# Autodesk Inventor assembly: iterasi2
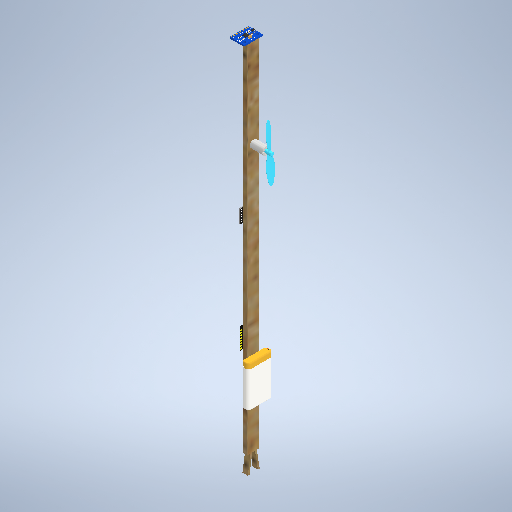
[picture p0: Inventor's stored thumbnail of the model, 512x512]
Saved by Autodesk Inventor 2026.2 (Build 302298010, 298A)
## iProperties
Created: 2026-11-09
Part Number: iterasi2
Document SubType Name: Assembly
Designer: Acer
Author: Acer
## Documents named in this file (8)
- D:\Cool Yeah\Semester 3\Praktikum SKD\Projek-Akhir\3Dmodel\iterasi2.iam
- D:\Cool Yeah\Semester 3\Praktikum SKD\Projek-Akhir\3Dmodel\propeller-65-mm-helice-65mm-1.snapshot.5\helice-ccw-65mm\helice-ccw-65mm\helice-ccw-65mm.ipt
- D:\Cool Yeah\Semester 3\Praktikum SKD\Projek-Akhir\3Dmodel\8520-coreless-brushed-motor-1.snapshot.2\8520 Coreless Brshed motor\8520 Coreless Brshed motor\8520 Coreless Brshed motor.ipt
- D:\Cool Yeah\Semester 3\Praktikum SKD\Projek-Akhir\3Dmodel\MPU6050\MPU6050 Accelerometer\MPU6050 Accelerometer\MPU6050 Accelerometer.ipt
- D:\Cool Yeah\Semester 3\Praktikum SKD\Projek-Akhir\3Dmodel\iterasi2.ipt
- D:\Cool Yeah\Semester 3\Praktikum SKD\Projek-Akhir\3Dmodel\mc-esp32-c3-super-mini-black-pink-red-1.snapshot.21\ESP32 C3 Super mini\ESP32 C3 Super mini\ESP32 C3 Super mini.ipt
- D:\Cool Yeah\Semester 3\Praktikum SKD\Projek-Akhir\3Dmodel\makerfocus-1100mah-lipo-battery-1.snapshot.1\1100mAh lipo v8\1100mAh lipo v8\1100mAh lipo v8.ipt
- D:\Cool Yeah\Semester 3\Praktikum SKD\Projek-Akhir\3Dmodel\drv8833-motor-driver-1.snapshot.2\DRV8833\DRV8833\DRV8833.ipt
## Components (7 placed, 7 different names)
1. 8520 Coreless Brshed motor:1 — Insert:1, Mate:6, Mate:7, Angle:1
2. MPU6050 Accelerometer:1 — Mate:1, Flush:1
3. iterasi2:1 — Insert:1, Mate:1, Flush:1, Mate:2, Flush:2, Mate:3, Flush:3, Mate:4
4. ESP32 C3 Super mini:2 — Mate:2, Flush:2, Mate:5
5. 1100mAh lipo v8:1 — Mate:3, Flush:3
6. DRV8833:2 — Mate:4, Mate:5
7. helice-ccw-65mm:1 — Mate:6, Mate:7, Angle:1
## Relationships (12: Mate 7, Flush 3, Insert 1, Angle 1)
- Insert:1: 8520 Coreless Brshed motor:1 ↔ iterasi2:1
- Mate:1: MPU6050 Accelerometer:1 ↔ iterasi2:1
- Flush:1: MPU6050 Accelerometer:1 ↔ iterasi2:1
- Mate:2: iterasi2:1 ↔ ESP32 C3 Super mini:2
- Flush:2 (-100 mm): iterasi2:1 ↔ ESP32 C3 Super mini:2
- Mate:3: iterasi2:1 ↔ 1100mAh lipo v8:1
- Flush:3 (50 mm): iterasi2:1 ↔ 1100mAh lipo v8:1
- Mate:4: iterasi2:1 ↔ DRV8833:2
- Mate:5 (100 mm): ESP32 C3 Super mini:2 ↔ DRV8833:2
- Mate:6: 8520 Coreless Brshed motor:1 ↔ helice-ccw-65mm:1
- Mate:7: 8520 Coreless Brshed motor:1 ↔ helice-ccw-65mm:1
- Angle:1 (0 deg): 8520 Coreless Brshed motor:1 ↔ helice-ccw-65mm:1
